# Autodesk Inventor assembly: Turbine
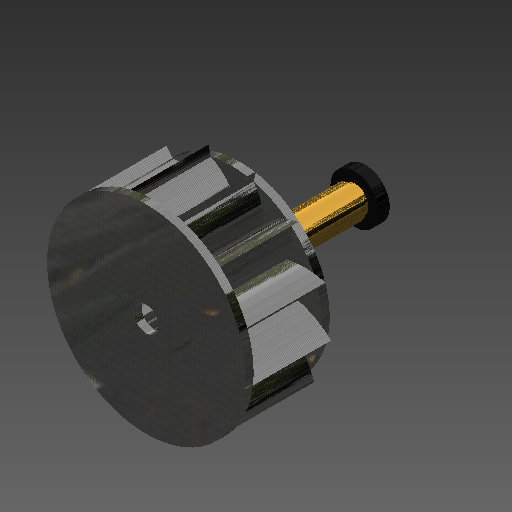
[picture p0: Inventor's stored thumbnail of the model, 512x512]
Saved by Autodesk Inventor 2026.1 (Build 301233020, 233B)
## iProperties
Created: 2026-10-21
Part Number: Turbine
Document SubType Name: Assembly
Designer: YmCris
Author: YmCris
## Documents named in this file (4)
- C:\Users\Fortune\Mechanical Engenieering\Fourth Semester\Mechanical Engineering Drawing\Inventor Projects\Classes\Assambling\Turbine\Turbine.iam
- C:\Users\Fortune\Mechanical Engenieering\Fourth Semester\Mechanical Engineering Drawing\Inventor Projects\Classes\Assambling\Turbine\Axixs-Turbine.ipt
- C:\Users\Fortune\Mechanical Engenieering\Fourth Semester\Mechanical Engineering Drawing\Inventor Projects\Classes\Assambling\Turbine\Bearing-Turbine.ipt
- C:\Users\Fortune\Mechanical Engenieering\Fourth Semester\Mechanical Engineering Drawing\Inventor Projects\Classes\Assambling\Turbine\Turbine.ipt
## Components (4 placed, 3 different names)
1. Axixs-Turbine:1 — Rigid:1, Rotational:1, Rotational:2, Angle:1
2. Turbine:1 — Rotational:2, Angle:1
3. Bearing-Turbine:2 — Rigid:1
4. Bearing-Turbine:3 — Rotational:1
## Relationships (4: RevoluteJoint 2, WeldJoint 1, Angle 1)
- Rigid:1 [WeldJoint]: Axixs-Turbine:1 ↔ Bearing-Turbine:2
- Rotational:1 [RevoluteJoint]: Axixs-Turbine:1 ↔ Bearing-Turbine:3
- Rotational:2 [RevoluteJoint]: Axixs-Turbine:1 ↔ Turbine:1
- Angle:1 (0 deg): Axixs-Turbine:1 ↔ Turbine:1
